# Autodesk Inventor assembly: 4_04_asm_Bobine
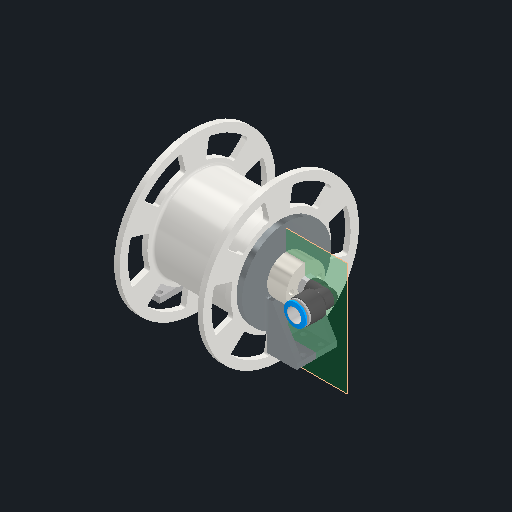
[picture p0: Inventor's stored thumbnail of the model, 512x512]
Saved by Autodesk Inventor 2026 (Build 300175000, 175)
## iProperties
Created: 2025-05-01
Part Number: 4_04_asm_Bobine
Document SubType Name: Assembly
Designer: Diogo
Author: Diogo
## Documents named in this file (4)
- C:\Users\remg9\OneDrive - HESSO\P2511_Dossier_partage_RVEZ\01_Robot\0101_CAO\4_Bobine\4_04_asm_Bobine.iam
- C:\Users\remg9\OneDrive - HESSO\P2511_Dossier_partage_RVEZ\01_Robot\0101_CAO\4_Bobine\4_02_Bobine v3.ipt
- C:\Users\remg9\OneDrive - HESSO\P2511_Dossier_partage_RVEZ\01_Robot\0101_CAO\4_Bobine\4_1_pied_avec_axe v7.ipt
- C:\Users\remg9\OneDrive - HESSO\P2511_Dossier_partage_RVEZ\01_Robot\0101_CAO\4_Bobine\essai_festo_1.iam
## Components (3 placed, 3 different names)
1. 4_02_Bobine v3:1 — Mate:1, Flush:3, Insert:1
2. 4_1_pied_avec_axe v7:1 — Mate:1, Flush:3
3. essai_festo_1:1 [sub-assembly] — Insert:1
## Relationships (3: Mate 1, Flush 1, Insert 1)
- Mate:1: 4_02_Bobine v3:1 ↔ 4_1_pied_avec_axe v7:1
- Flush:3: 4_02_Bobine v3:1 ↔ 4_1_pied_avec_axe v7:1
- Insert:1: 4_02_Bobine v3:1 ↔ essai_festo_1:1
## Named parameters: Finish1_Area = 860.581
note: some values were not read from the file. Shown as the stored number, unit unknown: "Finish1_Area".
